# Autodesk Inventor assembly: MM0937AN200_G03_818
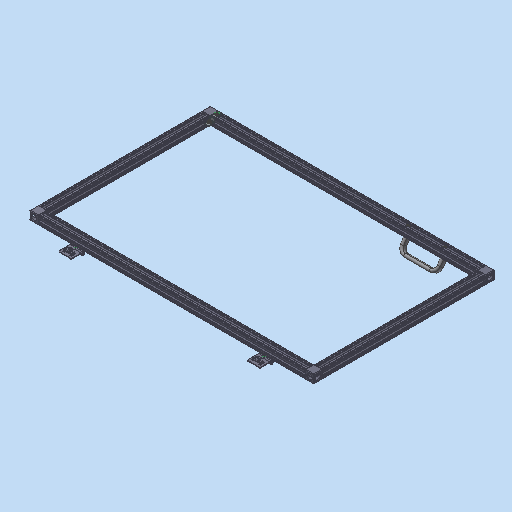
[picture p0: Inventor's stored thumbnail of the model, 512x512]
Saved by Autodesk Inventor 2023.3 (Build 273359000, 359)
## iProperties
Part Number: MM0937AN200_G03_818
Material: Generisch
Description: =<RBPARTNOTITLE>
Document SubType Name: Assembly
Designer: Benutzer
Mass: 3162.45 g
Surface Area: 11202.3 cm^2
Volume: 1148.18 cm^3
Density: 2.75431 g/cm^3
RBCHANGEDESCRIPTION1: Erstfreigabe
RBCHANGENO1: 00
RBDOCUMENTTYPE: DRF
RBDOCUMENTVERSION: 00
RBDRAWINGMAINSCALE: 1:1
RBDRAWINGMISSINGSPEC: --
RBDRAWINGVOLUME: --
RBDSV1: 0850
RBGBDETAILS: 43274
RBGBEDGESIN1: +0,5
RBGBEDGESIN2: +0,2
RBGBEDGESOUT1: -0,3
RBGBEDGESOUT2: -0,1
RBMATMEETS: --
RBMATNO: =<Part Number>
RBORGUNITRESPONSIBLE1: AnP/TEF1
RBPARTMADEOF: --
RBPARTNO: SIEHE MNR
RBPARTSAFETYINDICATOR: --
RBSURFACE: --
RBSURFACE2: --
RBZEDGESNORM: ISO13715:2002-06
RBZGENDIMCLASS: m
RBZGENDIMNORM: ISO 2768-1:1989-11
RBZGENGEOCLASS: H
RBZGENGEONORM: ISO 2768-2:1989-11
RBZSURFACENORM: ISO13D2:2002-02
RBZTOLERANCENORM: ISO 14405-1:2010-12
AnP_Kommentar: --
MaxAbmaße: --
AnP_TemplVers: 20190222
Author: Benutzer
Keywords: =<RBPARTMADEOF>
Revision Number: 01
## Documents named in this file (14)
- C:\Users\rea9an\Documents\Inventor\TCAI2412_te1910_EM\AS00000918.iam
- C:\Users\rea9an\Documents\Inventor\TCAI2412_te1910_EM\PT00004302.ipt
- C:\Users\rea9an\Documents\Inventor\TCAI2412_te1910_EM\PT00004317.ipt
- C:\Users\rea9an\Documents\Inventor\TCAI2412_te1910_EM\PT00004329.ipt
- C:\Users\rea9an\Documents\Inventor\TCAI2412_te1910_EM\PT00004466.ipt
- C:\Users\rea9an\Documents\Inventor\TCAI2412_te1910_EM\PT00004478.ipt
- C:\Users\rea9an\Documents\Inventor\TCAI2412_te1910_EM\PT00004467.ipt
- C:\Users\rea9an\Documents\Inventor\TCAI2412_te1910_EM\PT00004890.ipt
- C:\Users\rea9an\Documents\Inventor\TCAI2412_te1910_EM\PT00004483.ipt
- C:\Users\rea9an\Documents\Inventor\TCAI2412_te1910_EM\PT00004389.ipt
- C:\Users\rea9an\Documents\Inventor\TCAI2412_te1910_EM\PT00004290.ipt
- C:\Users\rea9an\Documents\Inventor\TCAI2412_te1910_EM\PT00004823.ipt
- C:\Users\rea9an\Documents\Inventor\TCAI2412_te1910_EM\PT00004779.ipt
- C:\Users\rea9an\Documents\Inventor\TCAI2412_te1910_EM\PT00004390.ipt
## Components (19 placed, 13 different names)
1. PT00004467:1 — Passend:13, Passend:15, Einfügen:8, Einfügen:9, Einfügen:10, Einfügen:11
2. PT00004466:1
3. PT00004329:2 — Passend:14
4. PT00004329:1
5. PT00004302:1
6. PT00004302:2
7. PT00004302:3 — Fluchtend:14
8. PT00004302:4 — Fluchtend:14
9. PT00004317:1 — Fluchtend:18, Fluchtend:19, Fluchtend:20
10. PT00004317:2 — Fluchtend:18, Fluchtend:19, Fluchtend:20
11. PT00004478:1 — Einfügen:8, Einfügen:9
12. PT00004890:1 — Einfügen:11
13. PT00004890:2 — Einfügen:10
14. PT00004483:1 — Passend:13, Passend:14, Passend:15, Einfügen:4, Einfügen:7
15. PT00004390:1
16. PT00004389:2 — Einfügen:3, Einfügen:4
17. PT00004290:1 — Einfügen:3
18. PT00004823:1 — Einfügen:6
19. PT00004779:1 — Einfügen:6, Einfügen:7
## Relationships (39: Flush 20, Mate 10, Insert 9)
- [Flush]: PT00004467:1 ↔ PT00004466:1
- [Flush]: PT00004467:1 ↔ PT00004466:1
- [Flush] (600 mm): PT00004467:1 ↔ PT00004466:1
- [Flush]: PT00004466:1 ↔ PT00004329:2
- [Flush] (15 mm): PT00004466:1 ↔ PT00004329:2
- [Mate] (-15 mm): PT00004467:1 ↔ PT00004329:2
- [Flush]: PT00004466:1 ↔ PT00004329:1
- [Flush]: PT00004329:2 ↔ PT00004329:1
- [Flush] (-945 mm): PT00004467:1 ↔ PT00004329:1
- [Mate]: PT00004329:2 ↔ PT00004302:1
- [Mate]: PT00004467:1 ↔ PT00004302:1
- [Flush]: PT00004329:2 ↔ PT00004302:1
- [Mate]: PT00004329:1 ↔ PT00004302:2
- [Flush]: PT00004329:1 ↔ PT00004302:2
- [Mate]: PT00004329:1 ↔ PT00004302:2
- [Flush] (-570 mm): PT00004329:2 ↔ PT00004302:4
- [Flush]: PT00004329:2 ↔ PT00004302:4
- [Flush]: PT00004466:1 ↔ PT00004329:2
- Fluchtend:14 [Flush]: PT00004302:3 ↔ PT00004302:4
- [Mate]: PT00004329:1 ↔ PT00004302:3
- [Mate]: PT00004466:1 ↔ PT00004302:3
- [Flush] (21 mm): PT00004466:1 ↔ PT00004317:1
- [Flush] (-136 mm): PT00004466:1 ↔ PT00004317:1
- [Flush] (17.5 mm): PT00004466:1 ↔ PT00004317:1
- Fluchtend:18 [Flush]: PT00004317:1 ↔ PT00004317:2
- Fluchtend:19 [Flush] (-657 mm): PT00004317:1 ↔ PT00004317:2
- Fluchtend:20 [Flush]: PT00004317:1 ↔ PT00004317:2
- Passend:13 [Mate]: PT00004467:1 ↔ PT00004483:1
- Passend:14 [Mate]: PT00004329:2 ↔ PT00004483:1
- Passend:15 [Mate] (1 mm): PT00004467:1 ↔ PT00004483:1
- Einfügen:3 [Insert] (1 mm): PT00004389:2 ↔ PT00004290:1
- Einfügen:4 [Insert]: PT00004483:1 ↔ PT00004389:2
- [Insert] (5 mm): PT00004390:1 ↔ PT00004779:1
- Einfügen:6 [Insert]: PT00004823:1 ↔ PT00004779:1
- Einfügen:7 [Insert]: PT00004483:1 ↔ PT00004779:1
- Einfügen:8 [Insert]: PT00004467:1 ↔ PT00004478:1
- Einfügen:9 [Insert]: PT00004467:1 ↔ PT00004478:1
- Einfügen:10 [Insert]: PT00004467:1 ↔ PT00004890:2
- Einfügen:11 [Insert]: PT00004467:1 ↔ PT00004890:1
